# Autodesk Inventor assembly: rotate-back
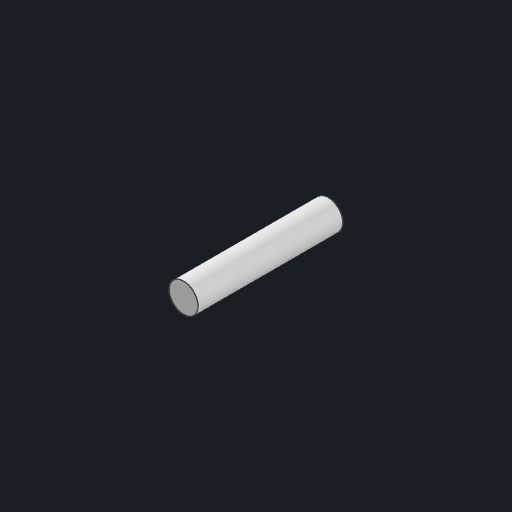
[picture p0: Inventor's stored thumbnail of the model, 512x512]
Saved by Autodesk Inventor 2026.1 (Build 301233000, 233)
## iProperties
Created: 2026-10-30
Part Number: rotate-back
Document SubType Name: Assembly
Designer: anony
Author: anony
## Documents named in this file (2)
- C:\Users\anony\OneDrive\Desktop\AI Projects\CAD Convert\corpus\generated\asm\rotate-back.iam
- C:\Users\anony\OneDrive\Desktop\AI Projects\CAD Convert\corpus\generated\asmparts\pin.ipt
## Components (2 placed, 1 different names)
1. pin:1 — Rotation:1
2. pin:2 — Rotation:1
## Relationships (1: RelateRotation 1)
- Rotation:1 [RelateRotation] (2 ul): pin:1 ↔ pin:2
